# Autodesk Inventor assembly: PneumaticGripper_v2
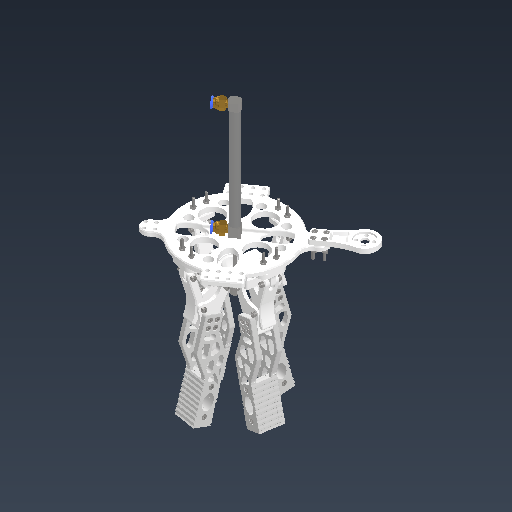
[picture p0: Inventor's stored thumbnail of the model, 512x512]
Saved by Autodesk Inventor 2026.2 (Build 302298010, 298A)
## iProperties
Created: 2026-05-08
Part Number: PneumaticGripper_v2
Document SubType Name: Assembly
Designer: work
Mass: 238.283 g
Surface Area: 643.3 cm^2
Volume: 109.497 cm^3
Density: 2.17616 g/cm^3
Author: work
## Documents named in this file (16)
- C:\Users\khw\Desktop\ARD_v1\ARD_hardware\PneumaticGripper_v2\PneumaticGripper_v2.iam
- C:\Users\khw\Desktop\ARD_v1\ARD_hardware\PneumaticGripper_v2\Pneumatic fitting\CDJ2B10_100\CDJ2B10.iam
- C:\Users\khw\Desktop\ARD_v1\ARD_hardware\PneumaticGripper_v2\Cylinder fixing parts.ipt
- C:\Users\khw\Desktop\ARD_v1\ARD_hardware\PneumaticGripper_v2\Pneumatic fitting\CDJ2B10_100\Rod.ipt
- C:\Users\khw\Desktop\ARD_v1\ARD_hardware\PneumaticGripper_v2\Bottom Link Parts.ipt
- C:\Users\khw\Desktop\ARD_v1\ARD_hardware\PneumaticGripper_v2\Link Support Parts.ipt
- C:\Users\khw\Desktop\ARD_v1\ARD_hardware\PneumaticGripper_v2\Link Parts.ipt
- C:\Users\khw\Desktop\ARD_v1\ARD_hardware\PneumaticGripper_v2\Flange Bracket.ipt
- C:\Users\khw\Desktop\ARD_v1\ARD_hardware\PneumaticGripper_v2\rod-fixing parts.ipt
- C:\Users\khw\Desktop\ARD_v1\ARD_hardware\PneumaticGripper_v2\TONGS SE\O-RING_R.ipt
- C:\Users\khw\Desktop\ARD_v1\ARD_hardware\PneumaticGripper_v2\TONGS SE\O-RING_L.ipt
- C:\Users\khw\Desktop\ARD_v1\ARD_hardware\PneumaticGripper_v2\Object\KS B 1003 - M 3 x 12.ipt
- C:\Users\khw\Desktop\ARD_v1\ARD_hardware\PneumaticGripper_v2\Object\KS B 1003 - M 3 x 20.ipt
- C:\Users\khw\Desktop\ARD_v1\ARD_hardware\PneumaticGripper_v2\Object\JIS B 1181 - A_B M3.ipt
- C:\Users\khw\Desktop\ARD_v1\ARD_hardware\PneumaticGripper_v2\Object\ANSI B18.2.4.5M - M6 x 1.ipt
- C:\Users\khw\Desktop\ARD_v1\ARD_hardware\PneumaticGripper_v2\Object\JIS B 1183 - M6x1(1).ipt
## Components (124 placed, 15 different names)
1. CDJ2B10:1 [sub-assembly] — 메이트:8, 메이트:28, 메이트:29, 각도:8
2. Cylinder fixing parts:1 — 메이트:27, 메이트:28, 메이트:29, 각도:8, 메이트:30, 메이트:31, 메이트:32, 메이트:37, 메이트:38, 메이트:39, 회전:1, 메이트:46, 메이트:50, 메이트:51, 메이트:52, 메이트:53, 삽입:81, 삽입:82, 삽입:83, 삽입:84, 삽입:85, 삽입:86, 삽입:87, 삽입:88, 삽입:89, 삽입:90, 삽입:91, 삽입:92
3. Rod:1 — 메이트:8, 메이트:54, 플러쉬:44
4. Flange Bracket:1 — 메이트:30, 메이트:31, 메이트:32, 삽입:69, 삽입:70, 삽입:71, 삽입:72
5. Link Support Parts:2 — 메이트:24, 메이트:25, 메이트:37, 메이트:38, 메이트:39, 플러쉬:43, 삽입:73, 삽입:74
6. Link Parts:3 — 메이트:24, 메이트:25, 플러쉬:38, 메이트:36, 삽입:24, 삽입:25
7. Bottom Link Parts:3 — 플러쉬:38, 메이트:36, 메이트:55, 메이트:62, 메이트:63, 메이트:64, 삽입:17, 삽입:18, 삽입:19, 삽입:20
8. Link Support Parts:3 — 메이트:50, 메이트:51, 플러쉬:42, 삽입:77, 삽입:78
9. Link Parts:4 — 삽입:51, 삽입:52
10. Bottom Link Parts:4 — 메이트:57, 메이트:68, 메이트:69, 메이트:70, 삽입:49, 삽입:50, 삽입:53, 삽입:58
11. Link Support Parts:4 — 회전:1, 메이트:46, 플러쉬:42, 삽입:75, 삽입:76
12. Link Parts:5 — 삽입:23, 삽입:61
13. Bottom Link Parts:5 — 메이트:58, 메이트:74, 메이트:75, 메이트:76, 삽입:21, 삽입:22, 삽입:60, 삽입:62
14. Link Support Parts:5 — 메이트:52, 메이트:53, 플러쉬:43, 삽입:79, 삽입:80
15. Link Parts:6 — 삽입:34, 삽입:35
16. Bottom Link Parts:6 — 메이트:56, 메이트:80, 메이트:81, 메이트:82, 삽입:26, 삽입:27, 삽입:36, 삽입:59
17. rod-fixing parts:1 — 메이트:54, 메이트:55, 메이트:56, 메이트:57, 메이트:58, 삽입:93, 삽입:94
18. O-RING_R:1 — 메이트:59, 메이트:60, 메이트:61, 메이트:62, 메이트:63, 삽입:11, 삽입:12, 삽입:13, 삽입:14, 삽입:15, 삽입:16
19. O-RING_L:1 — 메이트:59, 메이트:60, 메이트:61, 메이트:64, 삽입:9, 삽입:10, 삽입:95, 삽입:96, 삽입:97, 삽입:98
20. O-RING_R:2 — 메이트:68, 삽입:43, 삽입:44, 삽입:45, 삽입:46, 삽입:47, 삽입:48
21. O-RING_L:2 — 메이트:69, 메이트:70, 삽입:54, 삽입:55, 삽입:56, 삽입:57, 삽입:67, 삽입:68
22. O-RING_R:3 — 메이트:76, 삽입:1, 삽입:2, 삽입:3, 삽입:4, 삽입:5, 삽입:6
23. O-RING_L:3 — 메이트:74, 메이트:75, 삽입:7, 삽입:8, 삽입:63, 삽입:64, 삽입:65, 삽입:66
24. O-RING_R:4 — 메이트:80, 메이트:82, 삽입:37, 삽입:38, 삽입:39, 삽입:40, 삽입:41, 삽입:42
25. O-RING_L:4 — 메이트:81, 삽입:28, 삽입:29, 삽입:30, 삽입:31, 삽입:32, 삽입:33
26. KS B 1003 - M 3 x 12:1 — 삽입:1
27. KS B 1003 - M 3 x 12:2 — 삽입:2
28. KS B 1003 - M 3 x 12:3 — 삽입:3
29. KS B 1003 - M 3 x 12:4 — 삽입:4
30. KS B 1003 - M 3 x 12:5 — 삽입:5
31. KS B 1003 - M 3 x 12:6 — 삽입:6
32. KS B 1003 - M 3 x 12:7 — 삽입:7
33. KS B 1003 - M 3 x 12:8 — 삽입:8
34. KS B 1003 - M 3 x 12:9 — 삽입:9
35. KS B 1003 - M 3 x 12:10 — 삽입:10
36. KS B 1003 - M 3 x 12:11 — 삽입:11
37. KS B 1003 - M 3 x 12:12 — 삽입:12
38. KS B 1003 - M 3 x 12:13 — 삽입:13
39. KS B 1003 - M 3 x 12:14 — 삽입:14
40. KS B 1003 - M 3 x 12:15 — 삽입:15
41. KS B 1003 - M 3 x 12:16 — 삽입:16
42. KS B 1003 - M 3 x 12:17 — 삽입:17
43. KS B 1003 - M 3 x 12:18 — 삽입:18
44. KS B 1003 - M 3 x 12:19 — 삽입:19
45. KS B 1003 - M 3 x 12:20 — 삽입:20
46. KS B 1003 - M 3 x 12:21 — 삽입:21
47. KS B 1003 - M 3 x 12:22 — 삽입:22
48. KS B 1003 - M 3 x 12:23 — 삽입:23
49. KS B 1003 - M 3 x 12:24 — 삽입:24
50. KS B 1003 - M 3 x 12:25 — 삽입:25
51. KS B 1003 - M 3 x 12:26 — 삽입:26
52. KS B 1003 - M 3 x 12:27 — 삽입:27
53. KS B 1003 - M 3 x 12:28 — 삽입:28
54. KS B 1003 - M 3 x 12:29 — 삽입:29
55. KS B 1003 - M 3 x 12:30 — 삽입:30
56. KS B 1003 - M 3 x 12:31 — 삽입:31
57. KS B 1003 - M 3 x 12:32 — 삽입:32
58. KS B 1003 - M 3 x 12:33 — 삽입:33
59. KS B 1003 - M 3 x 12:34 — 삽입:34
60. KS B 1003 - M 3 x 12:35 — 삽입:35
61. KS B 1003 - M 3 x 12:36 — 삽입:36
62. KS B 1003 - M 3 x 12:37 — 삽입:37
63. KS B 1003 - M 3 x 12:38 — 삽입:38
64. KS B 1003 - M 3 x 12:39 — 삽입:39
65. KS B 1003 - M 3 x 12:40 — 삽입:40
66. KS B 1003 - M 3 x 12:41 — 삽입:41
67. KS B 1003 - M 3 x 12:42 — 삽입:42
68. KS B 1003 - M 3 x 12:43 — 삽입:43
69. KS B 1003 - M 3 x 12:44 — 삽입:44
70. KS B 1003 - M 3 x 12:45 — 삽입:45
71. KS B 1003 - M 3 x 12:46 — 삽입:46
72. KS B 1003 - M 3 x 12:47 — 삽입:47
73. KS B 1003 - M 3 x 12:48 — 삽입:48
74. KS B 1003 - M 3 x 12:49 — 삽입:49
75. KS B 1003 - M 3 x 12:50 — 삽입:50
76. KS B 1003 - M 3 x 12:51 — 삽입:51
77. KS B 1003 - M 3 x 12:52 — 삽입:52
78. KS B 1003 - M 3 x 12:53 — 삽입:53
79. KS B 1003 - M 3 x 12:54 — 삽입:54
80. KS B 1003 - M 3 x 12:55 — 삽입:55
81. KS B 1003 - M 3 x 12:56 — 삽입:56
82. KS B 1003 - M 3 x 12:57 — 삽입:57
83. KS B 1003 - M 3 x 12:58 — 삽입:58
84. KS B 1003 - M 3 x 12:59 — 삽입:59
85. KS B 1003 - M 3 x 12:60 — 삽입:60
86. KS B 1003 - M 3 x 12:61 — 삽입:61
87. KS B 1003 - M 3 x 12:62 — 삽입:62
88. KS B 1003 - M 3 x 12:63 — 삽입:63
89. KS B 1003 - M 3 x 12:64 — 삽입:64
90. KS B 1003 - M 3 x 12:65 — 삽입:65
91. KS B 1003 - M 3 x 12:66 — 삽입:66
92. KS B 1003 - M 3 x 12:67 — 삽입:67
93. KS B 1003 - M 3 x 12:68 — 삽입:68
94. KS B 1003 - M 3 x 20:1 — 삽입:69
95. KS B 1003 - M 3 x 20:2 — 삽입:70
96. KS B 1003 - M 3 x 20:3 — 삽입:71
97. KS B 1003 - M 3 x 20:4 — 삽입:72
98. KS B 1003 - M 3 x 20:5 — 삽입:73
99. KS B 1003 - M 3 x 20:6 — 삽입:74
100. KS B 1003 - M 3 x 20:7 — 삽입:75
101. KS B 1003 - M 3 x 20:8 — 삽입:76
102. KS B 1003 - M 3 x 20:9 — 삽입:77
103. KS B 1003 - M 3 x 20:10 — 삽입:78
104. KS B 1003 - M 3 x 20:11 — 삽입:79
105. KS B 1003 - M 3 x 20:12 — 삽입:80
106. JIS B 1181 - A_B M3:1 — 삽입:81
107. JIS B 1181 - A_B M3:2 — 삽입:82
108. JIS B 1181 - A_B M3:3 — 삽입:83
109. JIS B 1181 - A_B M3:4 — 삽입:84
110. JIS B 1181 - A_B M3:5 — 삽입:85
111. JIS B 1181 - A_B M3:6 — 삽입:86
112. JIS B 1181 - A_B M3:7 — 삽입:87
113. JIS B 1181 - A_B M3:8 — 삽입:88
114. JIS B 1181 - A_B M3:9 — 삽입:89
115. JIS B 1181 - A_B M3:10 — 삽입:90
116. JIS B 1181 - A_B M3:11 — 삽입:91
117. JIS B 1181 - A_B M3:12 — 삽입:92
118. ANSI B18.2.4.5M - M6 x 1:1 — 삽입:93, 플러쉬:44, 삽입:99
119. ANSI B18.2.4.5M - M6 x 1:2 — 삽입:94
120. KS B 1003 - M 3 x 12:69 — 삽입:95
121. KS B 1003 - M 3 x 12:70 — 삽입:96
122. KS B 1003 - M 3 x 12:71 — 삽입:97
123. KS B 1003 - M 3 x 12:72 — 삽입:98
124. JIS B 1183 - M6x1(1):1 — 삽입:99
## Relationships (164: Insert 99, Mate 56, Flush 7, Angle 1, RevoluteJoint 1)
- 메이트:8 [Mate]: CDJ2B10:1 ↔ Rod:1
- 메이트:24 [Mate]: Link Support Parts:2 ↔ Link Parts:3
- 메이트:25 [Mate]: Link Support Parts:2 ↔ Link Parts:3
- 메이트:27 [Mate] (150 mm): Cylinder fixing parts:1
- 메이트:28 [Mate]: CDJ2B10:1 ↔ Cylinder fixing parts:1
- 메이트:29 [Mate]: CDJ2B10:1 ↔ Cylinder fixing parts:1
- 각도:8 [Angle] (0 deg): CDJ2B10:1 ↔ Cylinder fixing parts:1
- 메이트:30 [Mate]: Cylinder fixing parts:1 ↔ Flange Bracket:1
- 메이트:31 [Mate]: Cylinder fixing parts:1 ↔ Flange Bracket:1
- 메이트:32 [Mate]: Cylinder fixing parts:1 ↔ Flange Bracket:1
- 플러쉬:38 [Flush]: Link Parts:3 ↔ Bottom Link Parts:3
- 메이트:36 [Mate]: Link Parts:3 ↔ Bottom Link Parts:3
- 메이트:37 [Mate]: Cylinder fixing parts:1 ↔ Link Support Parts:2
- 메이트:38 [Mate]: Cylinder fixing parts:1 ↔ Link Support Parts:2
- 메이트:39 [Mate]: Cylinder fixing parts:1 ↔ Link Support Parts:2
- [Mate]: Link Support Parts:3 ↔ Link Parts:4
- [Mate]: Link Support Parts:3 ↔ Link Parts:4
- [Flush]: Link Parts:4 ↔ Bottom Link Parts:4
- [Mate]: Link Parts:4 ↔ Bottom Link Parts:4
- [Mate]: Link Support Parts:4 ↔ Link Parts:5
- [Mate]: Link Support Parts:4 ↔ Link Parts:5
- [Flush]: Link Parts:5 ↔ Bottom Link Parts:5
- [Mate]: Link Parts:5 ↔ Bottom Link Parts:5
- 회전:1 [RevoluteJoint]: Cylinder fixing parts:1 ↔ Link Support Parts:4
- 메이트:46 [Mate]: Cylinder fixing parts:1 ↔ Link Support Parts:4
- [Mate]: Link Support Parts:5 ↔ Link Parts:6
- [Mate]: Link Support Parts:5 ↔ Link Parts:6
- [Flush]: Link Parts:6 ↔ Bottom Link Parts:6
- [Mate]: Link Parts:6 ↔ Bottom Link Parts:6
- 메이트:50 [Mate]: Cylinder fixing parts:1 ↔ Link Support Parts:3
- 메이트:51 [Mate]: Cylinder fixing parts:1 ↔ Link Support Parts:3
- 플러쉬:42 [Flush]: Link Support Parts:3 ↔ Link Support Parts:4
- 메이트:52 [Mate]: Cylinder fixing parts:1 ↔ Link Support Parts:5
- 메이트:53 [Mate]: Cylinder fixing parts:1 ↔ Link Support Parts:5
- 플러쉬:43 [Flush]: Link Support Parts:2 ↔ Link Support Parts:5
- 메이트:54 [Mate]: Rod:1 ↔ rod-fixing parts:1
- 메이트:55 [Mate]: Bottom Link Parts:3 ↔ rod-fixing parts:1
- 메이트:56 [Mate]: Bottom Link Parts:6 ↔ rod-fixing parts:1
- 메이트:57 [Mate]: Bottom Link Parts:4 ↔ rod-fixing parts:1
- 메이트:58 [Mate]: Bottom Link Parts:5 ↔ rod-fixing parts:1
- 메이트:59 [Mate]: O-RING_R:1 ↔ O-RING_L:1
- 메이트:60 [Mate]: O-RING_R:1 ↔ O-RING_L:1
- 메이트:61 [Mate]: O-RING_R:1 ↔ O-RING_L:1
- 메이트:62 [Mate]: Bottom Link Parts:3 ↔ O-RING_R:1
- 메이트:63 [Mate]: Bottom Link Parts:3 ↔ O-RING_R:1
- 메이트:64 [Mate]: Bottom Link Parts:3 ↔ O-RING_L:1
- [Mate]: O-RING_R:2 ↔ O-RING_L:2
- [Mate]: O-RING_R:2 ↔ O-RING_L:2
- [Mate]: O-RING_R:2 ↔ O-RING_L:2
- 메이트:68 [Mate]: Bottom Link Parts:4 ↔ O-RING_R:2
- 메이트:69 [Mate]: Bottom Link Parts:4 ↔ O-RING_L:2
- 메이트:70 [Mate]: Bottom Link Parts:4 ↔ O-RING_L:2
- [Mate]: O-RING_R:3 ↔ O-RING_L:3
- [Mate]: O-RING_R:3 ↔ O-RING_L:3
- [Mate]: O-RING_R:3 ↔ O-RING_L:3
- 메이트:74 [Mate]: Bottom Link Parts:5 ↔ O-RING_L:3
- 메이트:75 [Mate]: Bottom Link Parts:5 ↔ O-RING_L:3
- 메이트:76 [Mate]: Bottom Link Parts:5 ↔ O-RING_R:3
- [Mate]: O-RING_R:4 ↔ O-RING_L:4
- [Mate]: O-RING_R:4 ↔ O-RING_L:4
- [Mate]: O-RING_R:4 ↔ O-RING_L:4
- 메이트:80 [Mate]: Bottom Link Parts:6 ↔ O-RING_R:4
- 메이트:81 [Mate]: Bottom Link Parts:6 ↔ O-RING_L:4
- 메이트:82 [Mate]: Bottom Link Parts:6 ↔ O-RING_R:4
- 삽입:1 [Insert]: O-RING_R:3 ↔ KS B 1003 - M 3 x 12:1
- 삽입:2 [Insert]: O-RING_R:3 ↔ KS B 1003 - M 3 x 12:2
- 삽입:3 [Insert]: O-RING_R:3 ↔ KS B 1003 - M 3 x 12:3
- 삽입:4 [Insert]: O-RING_R:3 ↔ KS B 1003 - M 3 x 12:4
- 삽입:5 [Insert]: O-RING_R:3 ↔ KS B 1003 - M 3 x 12:5
- 삽입:6 [Insert]: O-RING_R:3 ↔ KS B 1003 - M 3 x 12:6
- 삽입:7 [Insert]: O-RING_L:3 ↔ KS B 1003 - M 3 x 12:7
- 삽입:8 [Insert]: O-RING_L:3 ↔ KS B 1003 - M 3 x 12:8
- 삽입:9 [Insert]: O-RING_L:1 ↔ KS B 1003 - M 3 x 12:9
- 삽입:10 [Insert]: O-RING_L:1 ↔ KS B 1003 - M 3 x 12:10
- 삽입:11 [Insert]: O-RING_R:1 ↔ KS B 1003 - M 3 x 12:11
- 삽입:12 [Insert]: O-RING_R:1 ↔ KS B 1003 - M 3 x 12:12
- 삽입:13 [Insert]: O-RING_R:1 ↔ KS B 1003 - M 3 x 12:13
- 삽입:14 [Insert]: O-RING_R:1 ↔ KS B 1003 - M 3 x 12:14
- 삽입:15 [Insert]: O-RING_R:1 ↔ KS B 1003 - M 3 x 12:15
- 삽입:16 [Insert]: O-RING_R:1 ↔ KS B 1003 - M 3 x 12:16
- 삽입:17 [Insert]: Bottom Link Parts:3 ↔ KS B 1003 - M 3 x 12:17
- 삽입:18 [Insert]: Bottom Link Parts:3 ↔ KS B 1003 - M 3 x 12:18
- 삽입:19 [Insert]: Bottom Link Parts:3 ↔ KS B 1003 - M 3 x 12:19
- 삽입:20 [Insert]: Bottom Link Parts:3 ↔ KS B 1003 - M 3 x 12:20
- 삽입:21 [Insert]: Bottom Link Parts:5 ↔ KS B 1003 - M 3 x 12:21
- 삽입:22 [Insert]: Bottom Link Parts:5 ↔ KS B 1003 - M 3 x 12:22
- 삽입:23 [Insert]: Link Parts:5 ↔ KS B 1003 - M 3 x 12:23
- 삽입:24 [Insert]: Link Parts:3 ↔ KS B 1003 - M 3 x 12:24
- 삽입:25 [Insert]: Link Parts:3 ↔ KS B 1003 - M 3 x 12:25
- 삽입:26 [Insert]: Bottom Link Parts:6 ↔ KS B 1003 - M 3 x 12:26
- 삽입:27 [Insert]: Bottom Link Parts:6 ↔ KS B 1003 - M 3 x 12:27
- 삽입:28 [Insert]: O-RING_L:4 ↔ KS B 1003 - M 3 x 12:28
- 삽입:29 [Insert]: O-RING_L:4 ↔ KS B 1003 - M 3 x 12:29
- 삽입:30 [Insert]: O-RING_L:4 ↔ KS B 1003 - M 3 x 12:30
- 삽입:31 [Insert]: O-RING_L:4 ↔ KS B 1003 - M 3 x 12:31
- 삽입:32 [Insert]: O-RING_L:4 ↔ KS B 1003 - M 3 x 12:32
- 삽입:33 [Insert]: O-RING_L:4 ↔ KS B 1003 - M 3 x 12:33
- 삽입:34 [Insert]: Link Parts:6 ↔ KS B 1003 - M 3 x 12:34
- 삽입:35 [Insert]: Link Parts:6 ↔ KS B 1003 - M 3 x 12:35
- 삽입:36 [Insert]: Bottom Link Parts:6 ↔ KS B 1003 - M 3 x 12:36
- 삽입:37 [Insert]: O-RING_R:4 ↔ KS B 1003 - M 3 x 12:37
- 삽입:38 [Insert]: O-RING_R:4 ↔ KS B 1003 - M 3 x 12:38
- 삽입:39 [Insert]: O-RING_R:4 ↔ KS B 1003 - M 3 x 12:39
- 삽입:40 [Insert]: O-RING_R:4 ↔ KS B 1003 - M 3 x 12:40
- 삽입:41 [Insert]: O-RING_R:4 ↔ KS B 1003 - M 3 x 12:41
- 삽입:42 [Insert]: O-RING_R:4 ↔ KS B 1003 - M 3 x 12:42
- 삽입:43 [Insert]: O-RING_R:2 ↔ KS B 1003 - M 3 x 12:43
- 삽입:44 [Insert]: O-RING_R:2 ↔ KS B 1003 - M 3 x 12:44
- 삽입:45 [Insert]: O-RING_R:2 ↔ KS B 1003 - M 3 x 12:45
- 삽입:46 [Insert]: O-RING_R:2 ↔ KS B 1003 - M 3 x 12:46
- 삽입:47 [Insert]: O-RING_R:2 ↔ KS B 1003 - M 3 x 12:47
- 삽입:48 [Insert]: O-RING_R:2 ↔ KS B 1003 - M 3 x 12:48
- 삽입:49 [Insert]: Bottom Link Parts:4 ↔ KS B 1003 - M 3 x 12:49
- 삽입:50 [Insert]: Bottom Link Parts:4 ↔ KS B 1003 - M 3 x 12:50
- 삽입:51 [Insert]: Link Parts:4 ↔ KS B 1003 - M 3 x 12:51
- 삽입:52 [Insert]: Link Parts:4 ↔ KS B 1003 - M 3 x 12:52
- 삽입:53 [Insert]: Bottom Link Parts:4 ↔ KS B 1003 - M 3 x 12:53
- 삽입:54 [Insert]: O-RING_L:2 ↔ KS B 1003 - M 3 x 12:54
- 삽입:55 [Insert]: O-RING_L:2 ↔ KS B 1003 - M 3 x 12:55
- 삽입:56 [Insert]: O-RING_L:2 ↔ KS B 1003 - M 3 x 12:56
- 삽입:57 [Insert]: O-RING_L:2 ↔ KS B 1003 - M 3 x 12:57
- 삽입:58 [Insert]: Bottom Link Parts:4 ↔ KS B 1003 - M 3 x 12:58
- 삽입:59 [Insert]: Bottom Link Parts:6 ↔ KS B 1003 - M 3 x 12:59
- 삽입:60 [Insert]: Bottom Link Parts:5 ↔ KS B 1003 - M 3 x 12:60
- 삽입:61 [Insert]: Link Parts:5 ↔ KS B 1003 - M 3 x 12:61
- 삽입:62 [Insert]: Bottom Link Parts:5 ↔ KS B 1003 - M 3 x 12:62
- 삽입:63 [Insert]: O-RING_L:3 ↔ KS B 1003 - M 3 x 12:63
- 삽입:64 [Insert]: O-RING_L:3 ↔ KS B 1003 - M 3 x 12:64
- 삽입:65 [Insert]: O-RING_L:3 ↔ KS B 1003 - M 3 x 12:65
- 삽입:66 [Insert]: O-RING_L:3 ↔ KS B 1003 - M 3 x 12:66
- 삽입:67 [Insert]: O-RING_L:2 ↔ KS B 1003 - M 3 x 12:67
- 삽입:68 [Insert]: O-RING_L:2 ↔ KS B 1003 - M 3 x 12:68
- 삽입:69 [Insert]: Flange Bracket:1 ↔ KS B 1003 - M 3 x 20:1
- 삽입:70 [Insert]: Flange Bracket:1 ↔ KS B 1003 - M 3 x 20:2
- 삽입:71 [Insert]: Flange Bracket:1 ↔ KS B 1003 - M 3 x 20:3
- 삽입:72 [Insert]: Flange Bracket:1 ↔ KS B 1003 - M 3 x 20:4
- 삽입:73 [Insert]: Link Support Parts:2 ↔ KS B 1003 - M 3 x 20:5
- 삽입:74 [Insert]: Link Support Parts:2 ↔ KS B 1003 - M 3 x 20:6
- 삽입:75 [Insert]: Link Support Parts:4 ↔ KS B 1003 - M 3 x 20:7
- 삽입:76 [Insert]: Link Support Parts:4 ↔ KS B 1003 - M 3 x 20:8
- 삽입:77 [Insert]: Link Support Parts:3 ↔ KS B 1003 - M 3 x 20:9
- 삽입:78 [Insert]: Link Support Parts:3 ↔ KS B 1003 - M 3 x 20:10
- 삽입:79 [Insert]: Link Support Parts:5 ↔ KS B 1003 - M 3 x 20:11
- 삽입:80 [Insert]: Link Support Parts:5 ↔ KS B 1003 - M 3 x 20:12
- 삽입:81 [Insert]: Cylinder fixing parts:1 ↔ JIS B 1181 - A_B M3:1
- 삽입:82 [Insert]: Cylinder fixing parts:1 ↔ JIS B 1181 - A_B M3:2
- 삽입:83 [Insert]: Cylinder fixing parts:1 ↔ JIS B 1181 - A_B M3:3
- 삽입:84 [Insert]: Cylinder fixing parts:1 ↔ JIS B 1181 - A_B M3:4
- 삽입:85 [Insert]: Cylinder fixing parts:1 ↔ JIS B 1181 - A_B M3:5
- 삽입:86 [Insert]: Cylinder fixing parts:1 ↔ JIS B 1181 - A_B M3:6
- 삽입:87 [Insert]: Cylinder fixing parts:1 ↔ JIS B 1181 - A_B M3:7
- 삽입:88 [Insert]: Cylinder fixing parts:1 ↔ JIS B 1181 - A_B M3:8
- 삽입:89 [Insert]: Cylinder fixing parts:1 ↔ JIS B 1181 - A_B M3:9
- 삽입:90 [Insert]: Cylinder fixing parts:1 ↔ JIS B 1181 - A_B M3:10
- 삽입:91 [Insert]: Cylinder fixing parts:1 ↔ JIS B 1181 - A_B M3:11
- 삽입:92 [Insert]: Cylinder fixing parts:1 ↔ JIS B 1181 - A_B M3:12
- 삽입:93 [Insert]: rod-fixing parts:1 ↔ ANSI B18.2.4.5M - M6 x 1:1
- 삽입:94 [Insert]: rod-fixing parts:1 ↔ ANSI B18.2.4.5M - M6 x 1:2
- 플러쉬:44 [Flush] (-5 mm): Rod:1 ↔ ANSI B18.2.4.5M - M6 x 1:1
- 삽입:95 [Insert]: O-RING_L:1 ↔ KS B 1003 - M 3 x 12:69
- 삽입:96 [Insert]: O-RING_L:1 ↔ KS B 1003 - M 3 x 12:70
- 삽입:97 [Insert]: O-RING_L:1 ↔ KS B 1003 - M 3 x 12:71
- 삽입:98 [Insert]: O-RING_L:1 ↔ KS B 1003 - M 3 x 12:72
- 삽입:99 [Insert]: ANSI B18.2.4.5M - M6 x 1:1 ↔ JIS B 1183 - M6x1(1):1
## Named parameters: d151_d146 = 0 mm, d152_d147 = 0 mm, d153_d33 = 0 mm, d154_d34 = 0 mm, d155_d146 = 0 mm, d156_d147 = 0 mm, d157_d33 = 0 mm, d158_d34 = 0 mm, d162_d151_d146 = 0 mm, d163_d152_d147 = 0 mm, d164_d153_d33 = 0 mm, d165_d154_d34 = 0 mm, d183_d177 = 0 mm, d184_d178 = 0 mm, d185_d179 = 0 mm, d189_d177 = 0 mm, d190_d178 = 0 mm, d191_d179 = 0 mm, d195_d177 = 0 mm, d196_d178 = 0 mm, d197_d179 = 0 mm
